# Autodesk Inventor assembly: MM0937AN200_G04_822
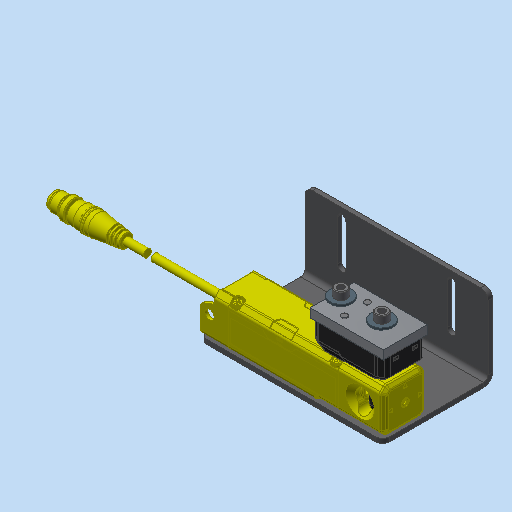
[picture p0: Inventor's stored thumbnail of the model, 512x512]
Saved by Autodesk Inventor 2023.3 (Build 273359000, 359)
## iProperties
Part Number: MM0937AN200_G04_822
Material: Generisch
Description: =<RBPARTNOTITLE2>
Document SubType Name: Assembly
Designer: Benutzer
Mass: 489.756 g
Surface Area: 668.084 cm^2
Volume: 153.116 cm^3
Density: 3.1986 g/cm^3
RBCHANGEDESCRIPTION1: Erstfreigabe
RBCHANGENO1: 00
RBDOCUMENTTYPE: DRF
RBDOCUMENTVERSION: 00
RBDRAWINGMAINSCALE: 1:1
RBDRAWINGMISSINGSPEC: --
RBDRAWINGVOLUME: --
RBDSV1: 0850
RBGBDETAILS: 43274
RBGBEDGESIN1: +0,5
RBGBEDGESIN2: +0,2
RBGBEDGESOUT1: -0,3
RBGBEDGESOUT2: -0,1
RBMATERIAL: =<Material>
RBMATMEETS: --
RBMATNO: =<Part Number>
RBORGUNITRESPONSIBLE1: AnP/TEF1
RBPARTMADEOF: --
RBPARTNO: SIEHE MNR
RBPARTNOTITLE1: enter description here
RBPARTNOTITLE2: hier Bezeichnung eintragen
RBPARTSAFETYINDICATOR: --
RBSURFACE: --
RBSURFACE2: --
RBZEDGESNORM: ISO13715:2002-06
RBZGENDIMCLASS: m
RBZGENDIMNORM: ISO 2768-1:1989-11
RBZGENGEOCLASS: H
RBZGENGEONORM: ISO 2768-2:1989-11
RBZSURFACENORM: ISO13D2:2002-02
RBZTOLERANCENORM: ISO 14405-1:2010-12
AnP_Kommentar: --
MaxAbmaße: --
AnP_TemplVers: 20190222
AnP_Material: =<Material>
Author: Benutzer
Keywords: =<RBPARTMADEOF>
Comments: =<RBSURFACE2>
Revision Number: 01
## Documents named in this file (8)
- C:\Users\rea9an\Documents\Inventor\TCAI2412_te1910_EM\AS00000922.iam
- C:\Users\rea9an\Documents\Inventor\TCAI2412_te1910_EM\PT00004396.ipt
- C:\Users\rea9an\Documents\Inventor\TCAI2412_te1910_EM\PT00004399.ipt
- C:\Users\rea9an\Documents\Inventor\TCAI2412_te1910_EM\PT00004568.ipt
- C:\Users\rea9an\Documents\Inventor\TCAI2412_te1910_EM\PT00004569.ipt
- C:\Users\rea9an\Documents\Inventor\TCAI2412_te1910_EM\PT00004884.ipt
- C:\Users\rea9an\Documents\Inventor\TCAI2412_te1910_EM\PT00004784.ipt
- C:\Users\rea9an\Documents\Inventor\TCAI2412_te1910_EM\PT00004409.ipt
## Components (12 placed, 7 different names)
1. PT00004568:1 — Einfügen:1, Einfügen:2, Fluchtend:1, Winkel:1
2. PT00004396:1 — Einfügen:1, Einfügen:2, Passend:1, Einfügen:17, Einfügen:18
3. PT00004399:1 — Passend:1, Fluchtend:1, Winkel:1, Einfügen:3, Einfügen:4
4. PT00004569:1 — Einfügen:3, Einfügen:4, Einfügen:11, Einfügen:12, Einfügen:13, Einfügen:14
5. PT00004884:1 — Einfügen:11, Einfügen:15
6. PT00004884:2 — Einfügen:12, Einfügen:16
7. PT00004884:3 — Einfügen:13
8. PT00004884:4 — Einfügen:14
9. PT00004784:1 — Einfügen:16
10. PT00004784:2 — Einfügen:15
11. PT00004409:1 — Einfügen:18
12. PT00004409:2 — Einfügen:17
## Relationships (15: Insert 12, Mate 1, Flush 1, Angle 1)
- Einfügen:1 [Insert]: PT00004568:1 ↔ PT00004396:1
- Einfügen:2 [Insert]: PT00004568:1 ↔ PT00004396:1
- Passend:1 [Mate]: PT00004396:1 ↔ PT00004399:1
- Fluchtend:1 [Flush] (-47.5 mm): PT00004568:1 ↔ PT00004399:1
- Winkel:1 [Angle] (0 deg): PT00004568:1 ↔ PT00004399:1
- Einfügen:3 [Insert]: PT00004399:1 ↔ PT00004569:1
- Einfügen:4 [Insert]: PT00004399:1 ↔ PT00004569:1
- Einfügen:11 [Insert] (2.7 mm): PT00004569:1 ↔ PT00004884:1
- Einfügen:12 [Insert] (2.7 mm): PT00004569:1 ↔ PT00004884:2
- Einfügen:13 [Insert]: PT00004569:1 ↔ PT00004884:3
- Einfügen:14 [Insert]: PT00004569:1 ↔ PT00004884:4
- Einfügen:15 [Insert]: PT00004884:1 ↔ PT00004784:2
- Einfügen:16 [Insert]: PT00004884:2 ↔ PT00004784:1
- Einfügen:17 [Insert]: PT00004396:1 ↔ PT00004409:2
- Einfügen:18 [Insert]: PT00004396:1 ↔ PT00004409:1
